# Autodesk Inventor assembly: Assembly1
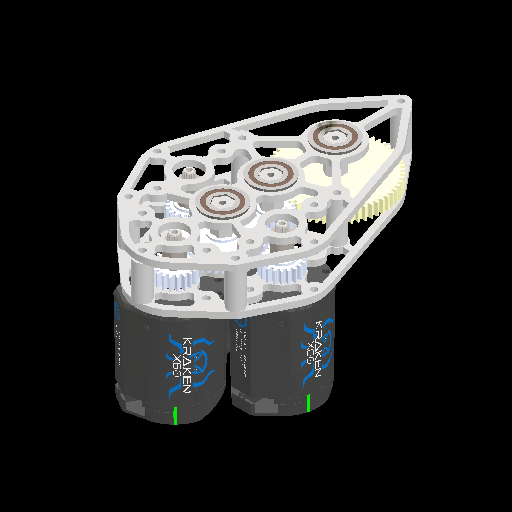
[picture p0: Inventor's stored thumbnail of the model, 512x512]
Saved by Autodesk Inventor 2027.1 (Build 311270010, 270A)
## iProperties
Created: 2026-10-31
Part Number: Assembly1
Document SubType Name: Assembly
Designer: Stanley Ruangsuwan
Author: Stanley Ruangsuwan
## Documents named in this file (10)
- C:\Users\stanr\Documents\GitHub\2026-2027-DesignTraining\Stan\lightening gearbox 5\Assembly1.iam
- C:\Users\stanr\Documents\GitHub\2026-2027-DesignTraining\Stan\lightening gearbox 5\gb5_001_plate.ipt
- C:\Users\stanr\Documents\GitHub\2026-2027-DesignTraining\Stan\Gearbox4\Gearbox4_002_Standoff.ipt
- C:\Users\stanr\Documents\GitHub\2026-2027-DesignTraining\COTS Library\Motion\Bearings\COTS_WCP-0783_1.125ODHexBearing.ipt
- C:\Users\stanr\Documents\GitHub\2026-2027-DesignTraining\Stan\Gearbox4\Gearbox4_003_Hexshaft.ipt
- C:\Users\stanr\Documents\GitHub\2026-2027-DesignTraining\COTS Library\Motors\COTS_WCP-0940_KrakenX60_New.ipt
- C:\Users\stanr\Documents\GitHub\2026-2027-DesignTraining\COTS Library\Adapters\COTS_WCP-1118_splinexsHexAdapter.ipt
- C:\Users\stanr\Documents\GitHub\2026-2027-DesignTraining\COTS Library\Motion\Gears\20DP gears\Aluminum\COTS_WCP-0711_40T_0.5inHex.ipt
- C:\Users\stanr\Documents\GitHub\2026-2027-DesignTraining\COTS Library\Motion\Gears\20DP gears\Aluminum\COTS_WCP-0701_20T_0.5inHex.ipt
- C:\Users\stanr\Documents\GitHub\2026-2027-DesignTraining\COTS Library\Motion\Gears\20DP gears\Aluminum\COTS_WCP-0720_60T_0.5inHex.ipt
## Components (29 placed, 9 different names)
1. gb5_001_plate:1 — Mate:1, Mate:2, Mate:3, Mate:4, Mate:5, Mate:6, Mate:7, Mate:8, Mate:9, Mate:10, Mate:11, Mate:12, Mate:13, Mate:14, Mate:15, Mate:16, Mate:20, Mate:21, Mate:22, Mate:24, Mate:25, Mate:26, Mate:27, Mate:28, Mate:29, Mate:54, Mate:55
2. Gearbox4_002_Standoff:1 — Mate:2, Mate:5
3. Gearbox4_002_Standoff:2 — Mate:1, Mate:6
4. Gearbox4_002_Standoff:3 — Mate:3, Mate:4, Mate:57, Mate:58
5. COTS_WCP-0783_1.125ODHexBearing:1 — Mate:7, Mate:12, Mate:19, Flush:3, Mate:43
6. COTS_WCP-0783_1.125ODHexBearing:2 — Mate:8, Mate:11, Mate:18, Flush:2, Mate:51
7. COTS_WCP-0783_1.125ODHexBearing:3 — Mate:9, Mate:10, Mate:17, Flush:1, Mate:53
8. Gearbox4_002_Standoff:4 — Mate:13, Mate:16
9. Gearbox4_002_Standoff:5 — Mate:14, Mate:15
10. Gearbox4_003_Hexshaft:1 — Mate:17, Flush:1, Mate:52
11. Gearbox4_003_Hexshaft:2 — Mate:18, Flush:2, Mate:50
12. Gearbox4_003_Hexshaft:3 — Mate:19, Flush:3, Mate:42
13. COTS_WCP-0940_KrakenX60_New:1 — Mate:22, Mate:28, Mate:29, Mate:31, Mate:35, Mate:45, Mate:49
14. COTS_WCP-0940_KrakenX60_New:2 — Mate:20, Mate:25, Mate:26, Mate:32, Mate:33, Mate:46, Mate:48
15. COTS_WCP-0940_KrakenX60_New:3 — Mate:21, Mate:24, Mate:27, Mate:30, Mate:34, Mate:47
16. COTS_WCP-1118_splinexsHexAdapter:1 — Mate:30, Mate:34, Mate:44
17. COTS_WCP-1118_splinexsHexAdapter:2 — Mate:31, Mate:35
18. COTS_WCP-1118_splinexsHexAdapter:3 — Mate:32, Mate:33
19. COTS_WCP-0711_40T_0.5inHex:1 — Mate:42, Mate:43
20. COTS_WCP-0701_20T_0.5inHex:1 — Mate:46, Mate:48
21. COTS_WCP-0701_20T_0.5inHex:2 — Mate:45, Mate:49
22. COTS_WCP-0701_20T_0.5inHex:3 — Mate:44, Mate:47
23. COTS_WCP-0701_20T_0.5inHex:4 — Mate:50, Mate:51
24. COTS_WCP-0720_60T_0.5inHex:1 — Mate:52, Mate:53
25. gb5_001_plate:2 — Mate:56, Mate:57, Mate:58, Mate:59, Mate:60, Mate:61, Mate:62, Mate:63, Mate:64
26. Gearbox4_002_Standoff:6 — Mate:54, Mate:55, Mate:56
27. COTS_WCP-0783_1.125ODHexBearing:4 — Mate:61, Mate:63
28. COTS_WCP-0783_1.125ODHexBearing:5 — Mate:60, Mate:64
29. COTS_WCP-0783_1.125ODHexBearing:6 — Mate:59, Mate:62
## Relationships (60: Mate 57, Flush 3)
- Mate:1: gb5_001_plate:1 ↔ Gearbox4_002_Standoff:2
- Mate:2: gb5_001_plate:1 ↔ Gearbox4_002_Standoff:1
- Mate:3: gb5_001_plate:1 ↔ Gearbox4_002_Standoff:3
- Mate:4: gb5_001_plate:1 ↔ Gearbox4_002_Standoff:3
- Mate:5: gb5_001_plate:1 ↔ Gearbox4_002_Standoff:1
- Mate:6: gb5_001_plate:1 ↔ Gearbox4_002_Standoff:2
- Mate:7: gb5_001_plate:1 ↔ COTS_WCP-0783_1.125ODHexBearing:1
- Mate:8: gb5_001_plate:1 ↔ COTS_WCP-0783_1.125ODHexBearing:2
- Mate:9: gb5_001_plate:1 ↔ COTS_WCP-0783_1.125ODHexBearing:3
- Mate:10: gb5_001_plate:1 ↔ COTS_WCP-0783_1.125ODHexBearing:3
- Mate:11: gb5_001_plate:1 ↔ COTS_WCP-0783_1.125ODHexBearing:2
- Mate:12: gb5_001_plate:1 ↔ COTS_WCP-0783_1.125ODHexBearing:1
- Mate:13: gb5_001_plate:1 ↔ Gearbox4_002_Standoff:4
- Mate:14: gb5_001_plate:1 ↔ Gearbox4_002_Standoff:5
- Mate:15: gb5_001_plate:1 ↔ Gearbox4_002_Standoff:5
- Mate:16: gb5_001_plate:1 ↔ Gearbox4_002_Standoff:4
- Mate:17: COTS_WCP-0783_1.125ODHexBearing:3 ↔ Gearbox4_003_Hexshaft:1
- Mate:18: COTS_WCP-0783_1.125ODHexBearing:2 ↔ Gearbox4_003_Hexshaft:2
- Mate:19: COTS_WCP-0783_1.125ODHexBearing:1 ↔ Gearbox4_003_Hexshaft:3
- Flush:1: COTS_WCP-0783_1.125ODHexBearing:3 ↔ Gearbox4_003_Hexshaft:1
- Flush:2: COTS_WCP-0783_1.125ODHexBearing:2 ↔ Gearbox4_003_Hexshaft:2
- Flush:3: COTS_WCP-0783_1.125ODHexBearing:1 ↔ Gearbox4_003_Hexshaft:3
- Mate:20: gb5_001_plate:1 ↔ COTS_WCP-0940_KrakenX60_New:2
- Mate:21: gb5_001_plate:1 ↔ COTS_WCP-0940_KrakenX60_New:3
- Mate:22: gb5_001_plate:1 ↔ COTS_WCP-0940_KrakenX60_New:1
- Mate:24: gb5_001_plate:1 ↔ COTS_WCP-0940_KrakenX60_New:3
- Mate:25: gb5_001_plate:1 ↔ COTS_WCP-0940_KrakenX60_New:2
- Mate:26: gb5_001_plate:1 ↔ COTS_WCP-0940_KrakenX60_New:2
- Mate:27: gb5_001_plate:1 ↔ COTS_WCP-0940_KrakenX60_New:3
- Mate:28: gb5_001_plate:1 ↔ COTS_WCP-0940_KrakenX60_New:1
- Mate:29: gb5_001_plate:1 ↔ COTS_WCP-0940_KrakenX60_New:1
- Mate:30: COTS_WCP-0940_KrakenX60_New:3 ↔ COTS_WCP-1118_splinexsHexAdapter:1
- Mate:31: COTS_WCP-0940_KrakenX60_New:1 ↔ COTS_WCP-1118_splinexsHexAdapter:2
- Mate:32: COTS_WCP-0940_KrakenX60_New:2 ↔ COTS_WCP-1118_splinexsHexAdapter:3
- Mate:33: COTS_WCP-0940_KrakenX60_New:2 ↔ COTS_WCP-1118_splinexsHexAdapter:3
- Mate:34: COTS_WCP-0940_KrakenX60_New:3 ↔ COTS_WCP-1118_splinexsHexAdapter:1
- Mate:35: COTS_WCP-0940_KrakenX60_New:1 ↔ COTS_WCP-1118_splinexsHexAdapter:2
- Mate:42: Gearbox4_003_Hexshaft:3 ↔ COTS_WCP-0711_40T_0.5inHex:1
- Mate:43: COTS_WCP-0783_1.125ODHexBearing:1 ↔ COTS_WCP-0711_40T_0.5inHex:1
- Mate:44: COTS_WCP-1118_splinexsHexAdapter:1 ↔ COTS_WCP-0701_20T_0.5inHex:3
- Mate:45: COTS_WCP-0940_KrakenX60_New:1 ↔ COTS_WCP-0701_20T_0.5inHex:2
- Mate:46: COTS_WCP-0940_KrakenX60_New:2 ↔ COTS_WCP-0701_20T_0.5inHex:1
- Mate:47: COTS_WCP-0940_KrakenX60_New:3 ↔ COTS_WCP-0701_20T_0.5inHex:3
- Mate:48: COTS_WCP-0940_KrakenX60_New:2 ↔ COTS_WCP-0701_20T_0.5inHex:1
- Mate:49: COTS_WCP-0940_KrakenX60_New:1 ↔ COTS_WCP-0701_20T_0.5inHex:2
- Mate:50: Gearbox4_003_Hexshaft:2 ↔ COTS_WCP-0701_20T_0.5inHex:4
- Mate:51: COTS_WCP-0783_1.125ODHexBearing:2 ↔ COTS_WCP-0701_20T_0.5inHex:4
- Mate:52: Gearbox4_003_Hexshaft:1 ↔ COTS_WCP-0720_60T_0.5inHex:1
- Mate:53: COTS_WCP-0783_1.125ODHexBearing:3 ↔ COTS_WCP-0720_60T_0.5inHex:1
- Mate:54: gb5_001_plate:1 ↔ Gearbox4_002_Standoff:6
- Mate:55: gb5_001_plate:1 ↔ Gearbox4_002_Standoff:6
- Mate:56: gb5_001_plate:2 ↔ Gearbox4_002_Standoff:6
- Mate:57: Gearbox4_002_Standoff:3 ↔ gb5_001_plate:2
- Mate:58: Gearbox4_002_Standoff:3 ↔ gb5_001_plate:2
- Mate:59: gb5_001_plate:2 ↔ COTS_WCP-0783_1.125ODHexBearing:6
- Mate:60: gb5_001_plate:2 ↔ COTS_WCP-0783_1.125ODHexBearing:5
- Mate:61: gb5_001_plate:2 ↔ COTS_WCP-0783_1.125ODHexBearing:4
- Mate:62: gb5_001_plate:2 ↔ COTS_WCP-0783_1.125ODHexBearing:6
- Mate:63: gb5_001_plate:2 ↔ COTS_WCP-0783_1.125ODHexBearing:4
- Mate:64: gb5_001_plate:2 ↔ COTS_WCP-0783_1.125ODHexBearing:5
